# Autodesk Inventor assembly: AMS_Pompe
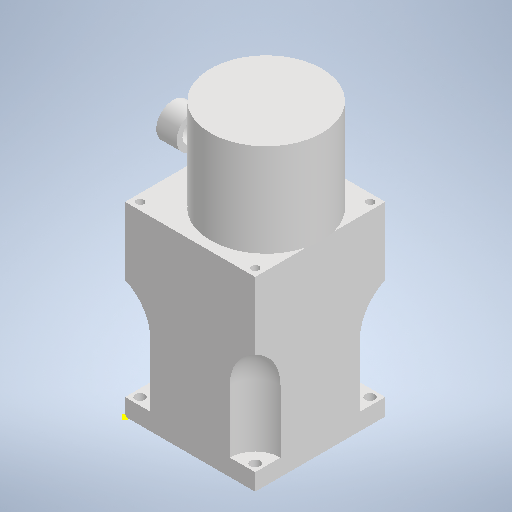
[picture p0: Inventor's stored thumbnail of the model, 512x512]
Saved by Autodesk Inventor 2025.3 (Build 293356000, 356)
## iProperties
Created: 2025-04-28
Part Number: AMS_Pompe
Document SubType Name: Assembly
Designer: karle
Author: karle
## Documents named in this file (3)
- C:\Users\karle\OneDrive - HESSO\P2511_Dossier_partage_RVEZ\01_Robot\0101_CAO\Pompe\AMS_Pompe.iam
- C:\Users\karle\OneDrive - HESSO\P2511_Dossier_partage_RVEZ\01_Robot\0101_CAO\Pompe\Pompe_model_1.1.ipt
- C:\Users\karle\OneDrive - HESSO\P2511_Dossier_partage_RVEZ\01_Robot\0101_CAO\Pompe\Supports_moteur_pompe.ipt
## Components (2 placed, 2 different names)
1. Pompe_model_1.1:1 — Einfügen:1
2. Supports_moteur_pompe:1 — Einfügen:1
## Relationships (1: Insert 1)
- Einfügen:1 [Insert]: Pompe_model_1.1:1 ↔ Supports_moteur_pompe:1
